(part 1 of 2)
# Autodesk Inventor assembly: Final Design v2
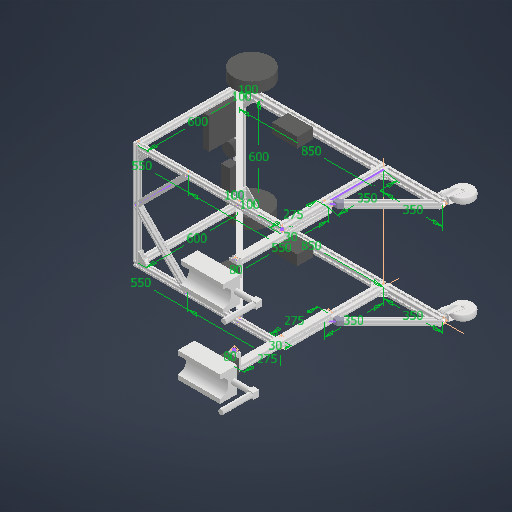
[picture p0: Inventor's stored thumbnail of the model, 512x512]
Saved by Autodesk Inventor 2026 (Build 300175050, 175E)
## iProperties
Created: 2026-09-14
Part Number: Final Design v2
Catalog Web Link: www.boschrexroth.com/brl
Description: Assembly
Vendor: Bosch Rexroth AG - BRL
Document SubType Name: Assembly
Designer: Anura
Mass: 32963.5 g
Surface Area: 66921.5 cm^2
Volume: 21111.2 cm^3
Density: 1.56143 g/cm^3
ProductId: Bosch Rexroth AG
Sending System: Bosch Rexroth AG
Author: Anura
## Documents named in this file (45)
- C:\Uni\Bachelorarbeit\CAD\Final Design v2\Final Design v2.iam
- Final Design v2.iam
- C:\Uni\Bachelorarbeit\CAD\Electronic Parts\Final Design Frame.ipt
- C:\Uni\Bachelorarbeit\CAD\Electronic Parts\Handles.ipt
- C:\Uni\Bachelorarbeit\CAD\Final Design v2\3842993724_STRUT PROFILE 40x40L_h150_260914151208250.ipt
- C:\Uni\Bachelorarbeit\CAD\Final Design v2\3842993724_STRUT PROFILE 40x40L_h150_260914151213792.ipt
- C:\Uni\Bachelorarbeit\CAD\Final Design v2\3842993724_STRUT PROFILE 40x40L_h150_260914151219216.ipt
- C:\Uni\Bachelorarbeit\CAD\Final Design v2\3842993724_STRUT PROFILE 40x40L_h150_260914151223655.ipt
- C:\Uni\Bachelorarbeit\CAD\Final Design v2\3842993724_STRUT PROFILE 40x40L_h150_260914151227681.ipt
- C:\Uni\Bachelorarbeit\CAD\Final Design v2\3842993710_STRUT PROFILE 30x45_h150_260914151454532.ipt
- C:\Uni\Bachelorarbeit\CAD\Final Design v2\3842993710_STRUT PROFILE 30x45_h150_260914151506771.ipt
- C:\Uni\Bachelorarbeit\CAD\Final Design v2\3842993710_STRUT PROFILE 30x45_h150_260914152027788.ipt
- C:\Uni\Bachelorarbeit\CAD\Final Design v2\3842993710_STRUT PROFILE 30x45_h150_260914152035980.ipt
- C:\Uni\Bachelorarbeit\CAD\Final Design v2\3842993710_STRUT PROFILE 30x45_h150_260914152234607.ipt
- C:\Uni\Bachelorarbeit\CAD\Final Design v2\3842993710_STRUT PROFILE 30x45_h150_260914152246414.ipt
- C:\Uni\Bachelorarbeit\CAD\Final Design v2\3842993703_STRUT PROFILE 30x30_h150_260914152755553.ipt
- C:\Uni\Bachelorarbeit\CAD\Final Design v2\3842993703_STRUT PROFILE 30x30_h150_260914152759129.ipt
- C:\Uni\Bachelorarbeit\CAD\Final Design v2\3842993703_STRUT PROFILE 30x30_h150_260914152806460.ipt
- C:\Uni\Bachelorarbeit\CAD\Final Design v2\3842993703_STRUT PROFILE 30x30_h150_260914152813741.ipt
- C:\Uni\Bachelorarbeit\CAD\Final Design v2\3842993703_STRUT PROFILE 30x30_h150_260914152817399.ipt
- C:\Uni\Bachelorarbeit\CAD\Final Design v2\3842993703_STRUT PROFILE 30x30_h150_260914152821085.ipt
- C:\Uni\Bachelorarbeit\CAD\Final Design v2\3842993703_STRUT PROFILE 30x30_h150_260914152832296.ipt
- C:\Uni\Bachelorarbeit\CAD\Final Design v2\3842993703_STRUT PROFILE 30x30_h150_260914152836142.ipt
- C:\Uni\Bachelorarbeit\CAD\Final Design v2\3842993703_STRUT PROFILE 30x30_h150_260914152843769.ipt
- C:\Uni\Bachelorarbeit\CAD\Final Design v2\3842993703_STRUT PROFILE 30x30_h150_260914152847624.ipt
- C:\Uni\Bachelorarbeit\CAD\Final Design v2\3842993703_STRUT PROFILE 30x30_h150_260915130417955.ipt
- C:\Uni\Bachelorarbeit\CAD\Final Design v2\3842993703_STRUT PROFILE 30x30_h150_260915130422752.ipt
- C:\Uni\Bachelorarbeit\CAD\Final Design v2\3842993703_STRUT PROFILE 30x30_h150_260915130427114.ipt
- C:\Uni\Bachelorarbeit\CAD\Final Design v2\3842993703_STRUT PROFILE 30x30_h150_260915130431463.ipt
- C:\Uni\Bachelorarbeit\CAD\Final Design v2\3842993703_STRUT PROFILE 30x30_h150_260915130435922.ipt
- C:\Uni\Bachelorarbeit\CAD\Final Design v2\3842993703_STRUT PROFILE 30x30_h150_260915130440308.ipt
- C:\Uni\Bachelorarbeit\CAD\Final Design v2\3842993703_STRUT PROFILE 30x30_h150_260915130444799.ipt
- C:\Uni\Bachelorarbeit\CAD\Final Design v2\3842993703_STRUT PROFILE 30x30_h150_260915130449323.ipt
- C:\Uni\Bachelorarbeit\CAD\Final Design v2\3842538683_Joint 30x30_150_260915130804560.iam
- C:\Uni\Bachelorarbeit\CAD\Final Design v2\3842554447_45° CONNECTOR, 30X30_h150_260915131009700_HD.ipt
- C:\Uni\Bachelorarbeit\CAD\Final Design v2\3842551604_GUSSET 40X80_h150_260915132254954_HD.ipt
- C:\Uni\Bachelorarbeit\CAD\Final Design v2\3842523541_GUSSET 30_60_h150_260915132538990_HD.ipt
- C:\Uni\Bachelorarbeit\CAD\Electronic Parts\Wheel.ipt
- C:\Uni\Bachelorarbeit\CAD\Final Design v1\3842541240_CASTER WHEEL_h150_260717015253432_HD.ipt
- C:\Uni\Bachelorarbeit\CAD\Electronic Parts\Forcesensor.ipt
- C:\Uni\Bachelorarbeit\CAD\Final Design v2\3842523530_GUSSET 30_30_h150_260919162252829_HD.ipt
- C:\Uni\Bachelorarbeit\CAD\Electronic Parts\Part11.ipt
- C:\Uni\Bachelorarbeit\CAD\Electronic Parts\MiniPC.ipt
- C:\Uni\Bachelorarbeit\CAD\Electronic Parts\lidar.ipt
- C:\Uni\Bachelorarbeit\CAD\Electronic Parts\powerbank.ipt
## Components (59 placed, 54 different names)
1. Final Design Frame:1 — BR_Constraint_Mate_091215121408026_P1, BR_Constraint_Mate_091215121408026_P2, BR_Constraint_Mate_091215121408026_P3, BR_Constraint_Mate_091215121408026_P4, BR_Constraint_Mate_091215151466926_P1, BR_Constraint_Mate_091215151466926_P2, BR_Constraint_Mate_091215151466926_P3, BR_Constraint_Mate_091215151466926_P4, BR_Constraint_Mate_091215211406126_P1, BR_Constraint_Mate_091215211406126_P2, BR_Constraint_Mate_091215211406126_P3, BR_Constraint_Mate_091215211406126_P4, BR_Constraint_Mate_091215251456626_P1, BR_Constraint_Mate_091215251456626_P2, BR_Constraint_Mate_091215251456626_P3, BR_Constraint_Mate_091215251456626_P4, BR_Constraint_Mate_091215291455626_P1, BR_Constraint_Mate_091215291455626_P2, BR_Constraint_Mate_091215291455626_P3, BR_Constraint_Mate_091215291455626_P4, BR_Constraint_Mate_091515011495426_P1, BR_Constraint_Mate_091515011495426_P2, BR_Constraint_Mate_091515011495426_P3, BR_Constraint_Mate_091515011495426_P4, BR_Constraint_Mate_091515081458926_P1, BR_Constraint_Mate_091515081458926_P2, BR_Constraint_Mate_091515081458926_P3, BR_Constraint_Mate_091515081458926_P4, BR_Constraint_Mate_092015301495626_P1, BR_Constraint_Mate_092015301495626_P2, BR_Constraint_Mate_092015301495626_P3, BR_Constraint_Mate_092015301495626_P4, BR_Constraint_Mate_092015391417226_P1, BR_Constraint_Mate_092015391417226_P2, BR_Constraint_Mate_092015391417226_P3, BR_Constraint_Mate_092015391417226_P4, BR_Constraint_Mate_092215381408426_P1, BR_Constraint_Mate_092215381408426_P2, BR_Constraint_Mate_092215381408426_P3, BR_Constraint_Mate_092215381408426_P4, BR_Constraint_Mate_092215501404826_P1, BR_Constraint_Mate_092215501404826_P2, BR_Constraint_Mate_092215501404826_P3, BR_Constraint_Mate_092215501404826_P4, BR_Constraint_Mate_092715581486526_P1, BR_Constraint_Mate_092715581486526_P2, BR_Constraint_Mate_092715581486526_P3, BR_Constraint_Mate_092715581486526_P4, BR_Constraint_Mate_092815021443226_P1, BR_Constraint_Mate_092815021443226_P2, BR_Constraint_Mate_092815021443226_P3, BR_Constraint_Mate_092815021443226_P4, BR_Constraint_Mate_092815091475826_P1, BR_Constraint_Mate_092815091475826_P2, BR_Constraint_Mate_092815091475826_P3, BR_Constraint_Mate_092815091475826_P4, BR_Constraint_Mate_092815171409326_P1, BR_Constraint_Mate_092815171409326_P2, BR_Constraint_Mate_092815171409326_P3, BR_Constraint_Mate_092815171409326_P4, BR_Constraint_Mate_092815201476326_P1, BR_Constraint_Mate_092815201476326_P2, BR_Constraint_Mate_092815201476326_P3, BR_Constraint_Mate_092815201476326_P4, BR_Constraint_Mate_092815241448326_P1, BR_Constraint_Mate_092815241448326_P2, BR_Constraint_Mate_092815241448326_P3, BR_Constraint_Mate_092815241448326_P4, BR_Constraint_Mate_092815351481726_P1, BR_Constraint_Mate_092815351481726_P2, BR_Constraint_Mate_092815351481726_P3, BR_Constraint_Mate_092815351481726_P4, BR_Constraint_Mate_092815391458826_P1, BR_Constraint_Mate_092815391458826_P2, BR_Constraint_Mate_092815391458826_P3, BR_Constraint_Mate_092815391458826_P4, BR_Constraint_Mate_092815471426826_P1, BR_Constraint_Mate_092815471426826_P2, BR_Constraint_Mate_092815471426826_P3, BR_Constraint_Mate_092815471426826_P4, BR_Constraint_Mate_092815511432826_P1, BR_Constraint_Mate_092815511432826_P2, BR_Constraint_Mate_092815511432826_P3, BR_Constraint_Mate_092815511432826_P4, BR_Constraint_Mate_090413221527926_P1, BR_Constraint_Mate_090413221527926_P2, BR_Constraint_Mate_090413221527926_P3, BR_Constraint_Mate_090413221527926_P4, BR_Constraint_Mate_090413261575826_P1, BR_Constraint_Mate_090413261575826_P2, BR_Constraint_Mate_090413261575826_P3, BR_Constraint_Mate_090413261575826_P4, BR_Constraint_Mate_090413311512826_P1, BR_Constraint_Mate_090413311512826_P2, BR_Constraint_Mate_090413311512826_P3, BR_Constraint_Mate_090413311512826_P4, BR_Constraint_Mate_090413351558326_P1, BR_Constraint_Mate_090413351558326_P2, BR_Constraint_Mate_090413351558326_P3, BR_Constraint_Mate_090413351558326_P4, BR_Constraint_Mate_090413391593726_P1, BR_Constraint_Mate_090413391593726_P2, BR_Constraint_Mate_090413391593726_P3, BR_Constraint_Mate_090413391593726_P4, BR_Constraint_Mate_090413441540226_P1, BR_Constraint_Mate_090413441540226_P2, BR_Constraint_Mate_090413441540226_P3, BR_Constraint_Mate_090413441540226_P4, BR_Constraint_Mate_090413481594026_P1, BR_Constraint_Mate_090413481594026_P2, BR_Constraint_Mate_090413481594026_P3, BR_Constraint_Mate_090413481594026_P4, BR_Constraint_Mate_090413531539226_P1, BR_Constraint_Mate_090413531539226_P2, BR_Constraint_Mate_090413531539226_P3, BR_Constraint_Mate_090413531539226_P4
2. Handles:1
3. Handles:2
4. Wheel:1
5. Wheel:2
6. 3842541240_CASTER WHEEL_h150_260717015253432_HD:1
7. 3842541240_CASTER WHEEL_h150_260717015253432_HD:2
8. Forcesensor:1
9. Forcesensor:2
10. Part11:1
11. Part11:2
12. MiniPC:1
13. lidar:1
14. powerbank:1
15. 3842993703_STRUT PROFILE 30x30_h150_260915130449323:1 — BR_Constraint_Mate_090413531539226_P1, BR_Constraint_Mate_090413531539226_P2, BR_Constraint_Mate_090413531539226_P3, BR_Constraint_Mate_090413531539226_P4, BR_Constraint_Angle_090413531539226_P5, BR_Constraint_Mate_TCon_FC_065265409111513_1_1, BR_Constraint_Mate_TCon_FC_065265409111513_2_2, BR_Constraint_Flush_FCon_FC_065265409111513_1_3
16. 3842993703_STRUT PROFILE 30x30_h150_260915130444799:1 — BR_Constraint_Mate_090413481594026_P1, BR_Constraint_Mate_090413481594026_P2, BR_Constraint_Mate_090413481594026_P3, BR_Constraint_Mate_090413481594026_P4, BR_Constraint_Angle_090413481594026_P5, BR_Constraint_Mate_TCon_FC_914260009111513_1_1, BR_Constraint_Mate_TCon_FC_914260009111513_2_2, BR_Constraint_Flush_FCon_FC_914260009111513_1_3
17. 3842993703_STRUT PROFILE 30x30_h150_260915130440308:1 — BR_Constraint_Mate_090413441540226_P1, BR_Constraint_Mate_090413441540226_P2, BR_Constraint_Mate_090413441540226_P3, BR_Constraint_Mate_090413441540226_P4, BR_Constraint_Angle_090413441540226_P5, BR_Constraint_Mate_BC_990263809251513_1_3, BR_Constraint_Mate_BC_887262809231916_1_3
18. 3842993703_STRUT PROFILE 30x30_h150_260915130435922:1 — BR_Constraint_Mate_090413391593726_P1, BR_Constraint_Mate_090413391593726_P2, BR_Constraint_Mate_090413391593726_P3, BR_Constraint_Mate_090413391593726_P4, BR_Constraint_Angle_090413391593726_P5, BR_Constraint_Flush_BC_470261209261513_1_1, BR_Constraint_Flush_BC_470261209261513_1_2
19. 3842993703_STRUT PROFILE 30x30_h150_260915130431463:1 — BR_Constraint_Mate_090413351558326_P1, BR_Constraint_Mate_090413351558326_P2, BR_Constraint_Mate_090413351558326_P3, BR_Constraint_Mate_090413351558326_P4, BR_Constraint_Angle_090413351558326_P5
20. 3842993703_STRUT PROFILE 30x30_h150_260915130427114:1 — BR_Constraint_Mate_090413311512826_P1, BR_Constraint_Mate_090413311512826_P2, BR_Constraint_Mate_090413311512826_P3, BR_Constraint_Mate_090413311512826_P4, BR_Constraint_Angle_090413311512826_P5, BR_Constraint_Mate_BC_990263809251513_1_1, BR_Constraint_Flush_BC_990263809251513_1_2, BR_Constraint_Mate_BC_470261209261513_1_3, BR_Constraint_Mate_BC_441262309231916_1_1, BR_Constraint_Mate_BC_441262309231916_1_2
21. 3842993703_STRUT PROFILE 30x30_h150_260915130422752:1 — BR_Constraint_Mate_090413261575826_P1, BR_Constraint_Mate_090413261575826_P2, BR_Constraint_Mate_090413261575826_P3, BR_Constraint_Mate_090413261575826_P4, BR_Constraint_Angle_090413261575826_P5, BR_Constraint_Mate_BC_441262309231916_1_3, BR_Constraint_Mate_BC_887262809231916_1_1, BR_Constraint_Flush_BC_887262809231916_1_2
22. 3842993703_STRUT PROFILE 30x30_h150_260915130417955:1 — BR_Constraint_Mate_090413221527926_P1, BR_Constraint_Mate_090413221527926_P2, BR_Constraint_Mate_090413221527926_P3, BR_Constraint_Mate_090413221527926_P4, BR_Constraint_Angle_090413221527926_P5, BR_Constraint_Mate_BC_955263809231916_1_3
23. 3842993703_STRUT PROFILE 30x30_h150_260914152847624:1 — BR_Constraint_Mate_092815511432826_P1, BR_Constraint_Mate_092815511432826_P2, BR_Constraint_Mate_092815511432826_P3, BR_Constraint_Mate_092815511432826_P4, BR_Constraint_Angle_092815511432826_P5
24. 3842993703_STRUT PROFILE 30x30_h150_260914152843769:1 — BR_Constraint_Mate_092815471426826_P1, BR_Constraint_Mate_092815471426826_P2, BR_Constraint_Mate_092815471426826_P3, BR_Constraint_Mate_092815471426826_P4, BR_Constraint_Angle_092815471426826_P5
25. 3842993703_STRUT PROFILE 30x30_h150_260914152836142:1 — BR_Constraint_Mate_092815391458826_P1, BR_Constraint_Mate_092815391458826_P2, BR_Constraint_Mate_092815391458826_P3, BR_Constraint_Mate_092815391458826_P4, BR_Constraint_Angle_092815391458826_P5
26. 3842993703_STRUT PROFILE 30x30_h150_260914152832296:1 — BR_Constraint_Mate_092815351481726_P1, BR_Constraint_Mate_092815351481726_P2, BR_Constraint_Mate_092815351481726_P3, BR_Constraint_Mate_092815351481726_P4, BR_Constraint_Angle_092815351481726_P5
27. 3842993703_STRUT PROFILE 30x30_h150_260914152821085:1 — BR_Constraint_Mate_092815241448326_P1, BR_Constraint_Mate_092815241448326_P2, BR_Constraint_Mate_092815241448326_P3, BR_Constraint_Mate_092815241448326_P4, BR_Constraint_Angle_092815241448326_P5
28. 3842993703_STRUT PROFILE 30x30_h150_260914152817399:1 — BR_Constraint_Mate_092815201476326_P1, BR_Constraint_Mate_092815201476326_P2, BR_Constraint_Mate_092815201476326_P3, BR_Constraint_Mate_092815201476326_P4, BR_Constraint_Angle_092815201476326_P5
29. 3842993703_STRUT PROFILE 30x30_h150_260914152813741:1 — BR_Constraint_Mate_092815171409326_P1, BR_Constraint_Mate_092815171409326_P2, BR_Constraint_Mate_092815171409326_P3, BR_Constraint_Mate_092815171409326_P4, BR_Constraint_Angle_092815171409326_P5, BR_Constraint_Mate_TCon_FC_759260609141513_1_1, BR_Constraint_Mate_TCon_FC_759260609141513_2_2, BR_Constraint_Flush_FCon_FC_759260609141513_1_3
30. 3842993703_STRUT PROFILE 30x30_h150_260914152806460:1 — BR_Constraint_Mate_092815091475826_P1, BR_Constraint_Mate_092815091475826_P2, BR_Constraint_Mate_092815091475826_P3, BR_Constraint_Mate_092815091475826_P4, BR_Constraint_Angle_092815091475826_P5, BR_Constraint_Mate_TCon_FC_422263309141513_1_1, BR_Constraint_Mate_TCon_FC_422263309141513_2_2, BR_Constraint_Flush_FCon_FC_422263309141513_1_3
31. 3842993703_STRUT PROFILE 30x30_h150_260914152759129:1 — BR_Constraint_Mate_092815021443226_P1, BR_Constraint_Mate_092815021443226_P2, BR_Constraint_Mate_092815021443226_P3, BR_Constraint_Mate_092815021443226_P4, BR_Constraint_Angle_092815021443226_P5
32. 3842993703_STRUT PROFILE 30x30_h150_260914152755553:1 — BR_Constraint_Mate_092715581486526_P1, BR_Constraint_Mate_092715581486526_P2, BR_Constraint_Mate_092715581486526_P3, BR_Constraint_Mate_092715581486526_P4, BR_Constraint_Angle_092715581486526_P5
33. 3842993710_STRUT PROFILE 30x45_h150_260914152246414:1 — BR_Constraint_Mate_092215501404826_P1, BR_Constraint_Mate_092215501404826_P2, BR_Constraint_Mate_092215501404826_P3, BR_Constraint_Mate_092215501404826_P4, BR_Constraint_Angle_092215501404826_P5, BR_Constraint_Mate_BC_492263609261916_1_3
34. 3842993710_STRUT PROFILE 30x45_h150_260914152234607:1 — BR_Constraint_Mate_092215381408426_P1, BR_Constraint_Mate_092215381408426_P2, BR_Constraint_Mate_092215381408426_P3, BR_Constraint_Mate_092215381408426_P4, BR_Constraint_Angle_092215381408426_P5
35. 3842993710_STRUT PROFILE 30x45_h150_260914152035980:1 — BR_Constraint_Mate_092015391417226_P1, BR_Constraint_Mate_092015391417226_P2, BR_Constraint_Mate_092015391417226_P3, BR_Constraint_Mate_092015391417226_P4, BR_Constraint_Angle_092015391417226_P5, BR_Constraint_Mate_BC_492263609261916_1_1, BR_Constraint_Mate_BC_492263609261916_1_2
36. 3842993710_STRUT PROFILE 30x45_h150_260914152027788:1 — BR_Constraint_Mate_092015301495626_P1, BR_Constraint_Mate_092015301495626_P2, BR_Constraint_Mate_092015301495626_P3, BR_Constraint_Mate_092015301495626_P4, BR_Constraint_Angle_092015301495626_P5
37. 3842993710_STRUT PROFILE 30x45_h150_260914151506771:1 — BR_Constraint_Mate_091515081458926_P1, BR_Constraint_Mate_091515081458926_P2, BR_Constraint_Mate_091515081458926_P3, BR_Constraint_Mate_091515081458926_P4, BR_Constraint_Angle_091515081458926_P5, BR_Constraint_Mate_BC_977262809241916_1_3, BR_Constraint_Mate_BC_648263509241916_1_3
38. 3842993710_STRUT PROFILE 30x45_h150_260914151454532:1 — BR_Constraint_Mate_091515011495426_P1, BR_Constraint_Mate_091515011495426_P2, BR_Constraint_Mate_091515011495426_P3, BR_Constraint_Mate_091515011495426_P4, BR_Constraint_Angle_091515011495426_P5, BR_Constraint_Mate_BC_830261309241916_1_3, BR_Constraint_Mate_BC_326262109241916_1_3
39. 3842993724_STRUT PROFILE 40x40L_h150_260914151227681:1 — BR_Constraint_Mate_091215291455626_P1, BR_Constraint_Mate_091215291455626_P2, BR_Constraint_Mate_091215291455626_P3, BR_Constraint_Mate_091215291455626_P4, BR_Constraint_Angle_091215291455626_P5, BR_Constraint_Mate_BC_954265409221513_1_3, BR_Constraint_Mate_BC_821261309231513_1_3, BR_Constraint_Mate_BC_955263809231916_1_1, BR_Constraint_Mate_BC_955263809231916_1_2
40. 3842993724_STRUT PROFILE 40x40L_h150_260914151223655:1 — BR_Constraint_Mate_091215251456626_P1, BR_Constraint_Mate_091215251456626_P2, BR_Constraint_Mate_091215251456626_P3, BR_Constraint_Mate_091215251456626_P4, BR_Constraint_Angle_091215251456626_P5, BR_Constraint_Flush_BC_326262109241916_1_1, BR_Constraint_Mate_BC_326262109241916_1_2
41. 3842993724_STRUT PROFILE 40x40L_h150_260914151219216:1 — BR_Constraint_Mate_091215211406126_P1, BR_Constraint_Mate_091215211406126_P2, BR_Constraint_Mate_091215211406126_P3, BR_Constraint_Mate_091215211406126_P4, BR_Constraint_Angle_091215211406126_P5, BR_Constraint_Mate_BC_821261309231513_1_1, BR_Constraint_Flush_BC_821261309231513_1_2, BR_Constraint_Mate_BC_830261309241916_1_1, BR_Constraint_Flush_BC_830261309241916_1_2
42. 3842993724_STRUT PROFILE 40x40L_h150_260914151213792:1 — BR_Constraint_Mate_091215151466926_P1, BR_Constraint_Mate_091215151466926_P2, BR_Constraint_Mate_091215151466926_P3, BR_Constraint_Mate_091215151466926_P4, BR_Constraint_Angle_091215151466926_P5, BR_Constraint_Flush_BC_648263509241916_1_1, BR_Constraint_Mate_BC_648263509241916_1_2
43. 3842993724_STRUT PROFILE 40x40L_h150_260914151208250:1 — BR_Constraint_Mate_091215121408026_P1, BR_Constraint_Mate_091215121408026_P2, BR_Constraint_Mate_091215121408026_P3, BR_Constraint_Mate_091215121408026_P4, BR_Constraint_Angle_091215121408026_P5, BR_Constraint_Flush_BC_954265409221513_1_1, BR_Constraint_Flush_BC_954265409221513_1_2, BR_Constraint_Flush_BC_977262809241916_1_1, BR_Constraint_Flush_BC_977262809241916_1_2
44. 3842523530_GUSSET 30_30_h150_260919162636492 — BR_Constraint_Mate_BC_492263609261916_1_1, BR_Constraint_Mate_BC_492263609261916_1_3, BR_Constraint_Mate_BC_492263609261916_1_2
45. 3842523530_GUSSET 30_30_h150_260919162435648 — BR_Constraint_Flush_BC_648263509241916_1_1, BR_Constraint_Mate_BC_648263509241916_1_3, BR_Constraint_Mate_BC_648263509241916_1_2
46. 3842523530_GUSSET 30_30_h150_260919162428977 — BR_Constraint_Flush_BC_977262809241916_1_1, BR_Constraint_Mate_BC_977262809241916_1_3, BR_Constraint_Flush_BC_977262809241916_1_2
47. 3842523530_GUSSET 30_30_h150_260919162421326 — BR_Constraint_Flush_BC_326262109241916_1_1, BR_Constraint_Mate_BC_326262109241916_1_3, BR_Constraint_Mate_BC_326262109241916_1_2
48. 3842523530_GUSSET 30_30_h150_260919162413830 — BR_Constraint_Mate_BC_830261309241916_1_1, BR_Constraint_Mate_BC_830261309241916_1_3, BR_Constraint_Flush_BC_830261309241916_1_2
49. 3842523530_GUSSET 30_30_h150_260919162338955 — BR_Constraint_Mate_BC_955263809231916_1_1, BR_Constraint_Mate_BC_955263809231916_1_3, BR_Constraint_Mate_BC_955263809231916_1_2
50. 3842523530_GUSSET 30_30_h150_260919162328887 — BR_Constraint_Mate_BC_887262809231916_1_1, BR_Constraint_Mate_BC_887262809231916_1_3, BR_Constraint_Flush_BC_887262809231916_1_2
51. 3842523530_GUSSET 30_30_h150_260919162323441 — BR_Constraint_Mate_BC_441262309231916_1_1, BR_Constraint_Mate_BC_441262309231916_1_3, BR_Constraint_Mate_BC_441262309231916_1_2
52. 3842523541_GUSSET 30_60_h150_260915132612470 — BR_Constraint_Flush_BC_470261209261513_1_1, BR_Constraint_Mate_BC_470261209261513_1_3, BR_Constraint_Flush_BC_470261209261513_1_2
53. 3842523541_GUSSET 30_60_h150_260915132538990 — BR_Constraint_Mate_BC_990263809251513_1_1, BR_Constraint_Mate_BC_990263809251513_1_3, BR_Constraint_Flush_BC_990263809251513_1_2
54. 3842551604_GUSSET 40X80_h150_260915132313821 — BR_Constraint_Mate_BC_821261309231513_1_1, BR_Constraint_Mate_BC_821261309231513_1_3, BR_Constraint_Flush_BC_821261309231513_1_2
55. 3842551604_GUSSET 40X80_h150_260915132254954 — BR_Constraint_Flush_BC_954265409221513_1_1, BR_Constraint_Mate_BC_954265409221513_1_3, BR_Constraint_Flush_BC_954265409221513_1_2
56. 3842554447_45° CONNECTOR, 30X30_h150_260915131433422 — BR_Constraint_Mate_TCon_FC_422263309141513_1_1, BR_Constraint_Mate_TCon_FC_422263309141513_2_2, BR_Constraint_Flush_FCon_FC_422263309141513_1_3
57. 3842554447_45° CONNECTOR, 30X30_h150_260915131406759 — BR_Constraint_Mate_TCon_FC_759260609141513_1_1, BR_Constraint_Mate_TCon_FC_759260609141513_2_2, BR_Constraint_Flush_FCon_FC_759260609141513_1_3
58. 3842554447_45° CONNECTOR, 30X30_h150_260915131154065 — BR_Constraint_Mate_TCon_FC_065265409111513_1_1, BR_Constraint_Mate_TCon_FC_065265409111513_2_2, BR_Constraint_Flush_FCon_FC_065265409111513_1_3
59. 3842554447_45° CONNECTOR, 30X30_h150_260915131100914 — BR_Constraint_Mate_TCon_FC_914260009111513_1_1, BR_Constraint_Mate_TCon_FC_914260009111513_2_2, BR_Constraint_Flush_FCon_FC_914260009111513_1_3
## Relationships (193: Mate 139, Angle 29, Flush 25)
- BR_Constraint_Mate_091215121408026_P1 [Mate]: Final Design Frame:1 ↔ 3842993724_STRUT PROFILE 40x40L_h150_260914151208250:1
- BR_Constraint_Mate_091215121408026_P2 [Mate]: Final Design Frame:1 ↔ 3842993724_STRUT PROFILE 40x40L_h150_260914151208250:1
- BR_Constraint_Mate_091215121408026_P3 [Mate] (-425 mm): Final Design Frame:1 ↔ 3842993724_STRUT PROFILE 40x40L_h150_260914151208250:1
- BR_Constraint_Mate_091215121408026_P4 [Mate] (425 mm): Final Design Frame:1 ↔ 3842993724_STRUT PROFILE 40x40L_h150_260914151208250:1
- BR_Constraint_Angle_091215121408026_P5 [Angle] (0 deg): 3842993724_STRUT PROFILE 40x40L_h150_260914151208250:1
- BR_Constraint_Mate_091215151466926_P1 [Mate]: Final Design Frame:1 ↔ 3842993724_STRUT PROFILE 40x40L_h150_260914151213792:1
- BR_Constraint_Mate_091215151466926_P2 [Mate]: Final Design Frame:1 ↔ 3842993724_STRUT PROFILE 40x40L_h150_260914151213792:1
- BR_Constraint_Mate_091215151466926_P3 [Mate] (-175 mm): Final Design Frame:1 ↔ 3842993724_STRUT PROFILE 40x40L_h150_260914151213792:1
- BR_Constraint_Mate_091215151466926_P4 [Mate] (175 mm): Final Design Frame:1 ↔ 3842993724_STRUT PROFILE 40x40L_h150_260914151213792:1
- BR_Constraint_Angle_091215151466926_P5 [Angle] (0 deg): 3842993724_STRUT PROFILE 40x40L_h150_260914151213792:1
- BR_Constraint_Mate_091215211406126_P1 [Mate]: Final Design Frame:1 ↔ 3842993724_STRUT PROFILE 40x40L_h150_260914151219216:1
- BR_Constraint_Mate_091215211406126_P2 [Mate]: Final Design Frame:1 ↔ 3842993724_STRUT PROFILE 40x40L_h150_260914151219216:1
- BR_Constraint_Mate_091215211406126_P3 [Mate] (-425 mm): Final Design Frame:1 ↔ 3842993724_STRUT PROFILE 40x40L_h150_260914151219216:1
- BR_Constraint_Mate_091215211406126_P4 [Mate] (425 mm): Final Design Frame:1 ↔ 3842993724_STRUT PROFILE 40x40L_h150_260914151219216:1
- BR_Constraint_Angle_091215211406126_P5 [Angle] (0 deg): 3842993724_STRUT PROFILE 40x40L_h150_260914151219216:1
- BR_Constraint_Mate_091215251456626_P1 [Mate]: Final Design Frame:1 ↔ 3842993724_STRUT PROFILE 40x40L_h150_260914151223655:1
- BR_Constraint_Mate_091215251456626_P2 [Mate]: Final Design Frame:1 ↔ 3842993724_STRUT PROFILE 40x40L_h150_260914151223655:1
- BR_Constraint_Mate_091215251456626_P3 [Mate] (-175 mm): Final Design Frame:1 ↔ 3842993724_STRUT PROFILE 40x40L_h150_260914151223655:1
- BR_Constraint_Mate_091215251456626_P4 [Mate] (175 mm): Final Design Frame:1 ↔ 3842993724_STRUT PROFILE 40x40L_h150_260914151223655:1
- BR_Constraint_Angle_091215251456626_P5 [Angle] (0 deg): 3842993724_STRUT PROFILE 40x40L_h150_260914151223655:1
- BR_Constraint_Mate_091215291455626_P1 [Mate]: Final Design Frame:1 ↔ 3842993724_STRUT PROFILE 40x40L_h150_260914151227681:1
- BR_Constraint_Mate_091215291455626_P2 [Mate]: Final Design Frame:1 ↔ 3842993724_STRUT PROFILE 40x40L_h150_260914151227681:1
- BR_Constraint_Mate_091215291455626_P3 [Mate] (-300 mm): Final Design Frame:1 ↔ 3842993724_STRUT PROFILE 40x40L_h150_260914151227681:1
- BR_Constraint_Mate_091215291455626_P4 [Mate] (300 mm): Final Design Frame:1 ↔ 3842993724_STRUT PROFILE 40x40L_h150_260914151227681:1
- BR_Constraint_Angle_091215291455626_P5 [Angle] (0 deg): 3842993724_STRUT PROFILE 40x40L_h150_260914151227681:1
- BR_Constraint_Mate_091515011495426_P1 [Mate]: Final Design Frame:1 ↔ 3842993710_STRUT PROFILE 30x45_h150_260914151454532:1
- BR_Constraint_Mate_091515011495426_P2 [Mate]: Final Design Frame:1 ↔ 3842993710_STRUT PROFILE 30x45_h150_260914151454532:1
- BR_Constraint_Mate_091515011495426_P3 [Mate] (-299.8546 mm): Final Design Frame:1 ↔ 3842993710_STRUT PROFILE 30x45_h150_260914151454532:1
- BR_Constraint_Mate_091515011495426_P4 [Mate] (299.8546 mm): Final Design Frame:1 ↔ 3842993710_STRUT PROFILE 30x45_h150_260914151454532:1
- BR_Constraint_Angle_091515011495426_P5 [Angle] (0 deg): 3842993710_STRUT PROFILE 30x45_h150_260914151454532:1
- BR_Constraint_Mate_091515081458926_P1 [Mate]: Final Design Frame:1 ↔ 3842993710_STRUT PROFILE 30x45_h150_260914151506771:1
- BR_Constraint_Mate_091515081458926_P2 [Mate]: Final Design Frame:1 ↔ 3842993710_STRUT PROFILE 30x45_h150_260914151506771:1
- BR_Constraint_Mate_091515081458926_P3 [Mate] (-300.0021 mm): Final Design Frame:1 ↔ 3842993710_STRUT PROFILE 30x45_h150_260914151506771:1
- BR_Constraint_Mate_091515081458926_P4 [Mate] (300.0021 mm): Final Design Frame:1 ↔ 3842993710_STRUT PROFILE 30x45_h150_260914151506771:1
- BR_Constraint_Angle_091515081458926_P5 [Angle] (0 deg): 3842993710_STRUT PROFILE 30x45_h150_260914151506771:1
- BR_Constraint_Mate_092015301495626_P1 [Mate]: Final Design Frame:1 ↔ 3842993710_STRUT PROFILE 30x45_h150_260914152027788:1
- BR_Constraint_Mate_092015301495626_P2 [Mate]: Final Design Frame:1 ↔ 3842993710_STRUT PROFILE 30x45_h150_260914152027788:1
- BR_Constraint_Mate_092015301495626_P3 [Mate] (-275 mm): Final Design Frame:1 ↔ 3842993710_STRUT PROFILE 30x45_h150_260914152027788:1
- BR_Constraint_Mate_092015301495626_P4 [Mate] (275 mm): Final Design Frame:1 ↔ 3842993710_STRUT PROFILE 30x45_h150_260914152027788:1
- BR_Constraint_Angle_092015301495626_P5 [Angle] (0 deg): 3842993710_STRUT PROFILE 30x45_h150_260914152027788:1
- BR_Constraint_Mate_092015391417226_P1 [Mate]: Final Design Frame:1 ↔ 3842993710_STRUT PROFILE 30x45_h150_260914152035980:1
- BR_Constraint_Mate_092015391417226_P2 [Mate]: Final Design Frame:1 ↔ 3842993710_STRUT PROFILE 30x45_h150_260914152035980:1
- BR_Constraint_Mate_092015391417226_P3 [Mate] (-275 mm): Final Design Frame:1 ↔ 3842993710_STRUT PROFILE 30x45_h150_260914152035980:1
- BR_Constraint_Mate_092015391417226_P4 [Mate] (275 mm): Final Design Frame:1 ↔ 3842993710_STRUT PROFILE 30x45_h150_260914152035980:1
- BR_Constraint_Angle_092015391417226_P5 [Angle] (0 deg): 3842993710_STRUT PROFILE 30x45_h150_260914152035980:1
- BR_Constraint_Mate_092215381408426_P1 [Mate]: Final Design Frame:1 ↔ 3842993710_STRUT PROFILE 30x45_h150_260914152234607:1
- BR_Constraint_Mate_092215381408426_P2 [Mate]: Final Design Frame:1 ↔ 3842993710_STRUT PROFILE 30x45_h150_260914152234607:1
- BR_Constraint_Mate_092215381408426_P3 [Mate] (-40 mm): Final Design Frame:1 ↔ 3842993710_STRUT PROFILE 30x45_h150_260914152234607:1
- BR_Constraint_Mate_092215381408426_P4 [Mate] (40 mm): Final Design Frame:1 ↔ 3842993710_STRUT PROFILE 30x45_h150_260914152234607:1
- BR_Constraint_Angle_092215381408426_P5 [Angle] (0 deg): 3842993710_STRUT PROFILE 30x45_h150_260914152234607:1
- BR_Constraint_Mate_092215501404826_P1 [Mate]: Final Design Frame:1 ↔ 3842993710_STRUT PROFILE 30x45_h150_260914152246414:1
- BR_Constraint_Mate_092215501404826_P2 [Mate]: Final Design Frame:1 ↔ 3842993710_STRUT PROFILE 30x45_h150_260914152246414:1
- BR_Constraint_Mate_092215501404826_P3 [Mate] (-40 mm): Final Design Frame:1 ↔ 3842993710_STRUT PROFILE 30x45_h150_260914152246414:1
- BR_Constraint_Mate_092215501404826_P4 [Mate] (40 mm): Final Design Frame:1 ↔ 3842993710_STRUT PROFILE 30x45_h150_260914152246414:1
- BR_Constraint_Angle_092215501404826_P5 [Angle] (0 deg): 3842993710_STRUT PROFILE 30x45_h150_260914152246414:1
- BR_Constraint_Mate_092715581486526_P1 [Mate]: Final Design Frame:1 ↔ 3842993703_STRUT PROFILE 30x30_h150_260914152755553:1
- BR_Constraint_Mate_092715581486526_P2 [Mate]: Final Design Frame:1 ↔ 3842993703_STRUT PROFILE 30x30_h150_260914152755553:1
- BR_Constraint_Mate_092715581486526_P3 [Mate] (-275 mm): Final Design Frame:1 ↔ 3842993703_STRUT PROFILE 30x30_h150_260914152755553:1
- BR_Constraint_Mate_092715581486526_P4 [Mate] (275 mm): Final Design Frame:1 ↔ 3842993703_STRUT PROFILE 30x30_h150_260914152755553:1
- BR_Constraint_Angle_092715581486526_P5 [Angle] (0 deg): 3842993703_STRUT PROFILE 30x30_h150_260914152755553:1
- BR_Constraint_Mate_092815021443226_P1 [Mate]: Final Design Frame:1 ↔ 3842993703_STRUT PROFILE 30x30_h150_260914152759129:1
- BR_Constraint_Mate_092815021443226_P2 [Mate]: Final Design Frame:1 ↔ 3842993703_STRUT PROFILE 30x30_h150_260914152759129:1
- BR_Constraint_Mate_092815021443226_P3 [Mate] (-275 mm): Final Design Frame:1 ↔ 3842993703_STRUT PROFILE 30x30_h150_260914152759129:1
- BR_Constraint_Mate_092815021443226_P4 [Mate] (275 mm): Final Design Frame:1 ↔ 3842993703_STRUT PROFILE 30x30_h150_260914152759129:1
- BR_Constraint_Angle_092815021443226_P5 [Angle] (0 deg): 3842993703_STRUT PROFILE 30x30_h150_260914152759129:1
- BR_Constraint_Mate_092815091475826_P1 [Mate]: Final Design Frame:1 ↔ 3842993703_STRUT PROFILE 30x30_h150_260914152806460:1
- BR_Constraint_Mate_092815091475826_P2 [Mate]: Final Design Frame:1 ↔ 3842993703_STRUT PROFILE 30x30_h150_260914152806460:1
- BR_Constraint_Mate_092815091475826_P3 [Mate] (-247.4874 mm): Final Design Frame:1 ↔ 3842993703_STRUT PROFILE 30x30_h150_260914152806460:1
- BR_Constraint_Mate_092815091475826_P4 [Mate] (247.4874 mm): Final Design Frame:1 ↔ 3842993703_STRUT PROFILE 30x30_h150_260914152806460:1
- BR_Constraint_Angle_092815091475826_P5 [Angle] (0 deg): 3842993703_STRUT PROFILE 30x30_h150_260914152806460:1
- BR_Constraint_Mate_092815171409326_P1 [Mate]: Final Design Frame:1 ↔ 3842993703_STRUT PROFILE 30x30_h150_260914152813741:1
- BR_Constraint_Mate_092815171409326_P2 [Mate]: Final Design Frame:1 ↔ 3842993703_STRUT PROFILE 30x30_h150_260914152813741:1
- BR_Constraint_Mate_092815171409326_P3 [Mate] (-247.4874 mm): Final Design Frame:1 ↔ 3842993703_STRUT PROFILE 30x30_h150_260914152813741:1
- BR_Constraint_Mate_092815171409326_P4 [Mate] (247.4874 mm): Final Design Frame:1 ↔ 3842993703_STRUT PROFILE 30x30_h150_260914152813741:1
- BR_Constraint_Angle_092815171409326_P5 [Angle] (0 deg): 3842993703_STRUT PROFILE 30x30_h150_260914152813741:1
- BR_Constraint_Mate_092815201476326_P1 [Mate]: Final Design Frame:1 ↔ 3842993703_STRUT PROFILE 30x30_h150_260914152817399:1
- BR_Constraint_Mate_092815201476326_P2 [Mate]: Final Design Frame:1 ↔ 3842993703_STRUT PROFILE 30x30_h150_260914152817399:1
- BR_Constraint_Mate_092815201476326_P3 [Mate] (-208.043 mm): Final Design Frame:1 ↔ 3842993703_STRUT PROFILE 30x30_h150_260914152817399:1
- BR_Constraint_Mate_092815201476326_P4 [Mate] (208.043 mm): Final Design Frame:1 ↔ 3842993703_STRUT PROFILE 30x30_h150_260914152817399:1
- BR_Constraint_Angle_092815201476326_P5 [Angle] (0 deg): 3842993703_STRUT PROFILE 30x30_h150_260914152817399:1
- BR_Constraint_Mate_092815241448326_P1 [Mate]: Final Design Frame:1 ↔ 3842993703_STRUT PROFILE 30x30_h150_260914152821085:1
- BR_Constraint_Mate_092815241448326_P2 [Mate]: Final Design Frame:1 ↔ 3842993703_STRUT PROFILE 30x30_h150_260914152821085:1
- BR_Constraint_Mate_092815241448326_P3 [Mate] (-214.7277 mm): Final Design Frame:1 ↔ 3842993703_STRUT PROFILE 30x30_h150_260914152821085:1
- BR_Constraint_Mate_092815241448326_P4 [Mate] (214.7277 mm): Final Design Frame:1 ↔ 3842993703_STRUT PROFILE 30x30_h150_260914152821085:1
- BR_Constraint_Angle_092815241448326_P5 [Angle] (0 deg): 3842993703_STRUT PROFILE 30x30_h150_260914152821085:1
- BR_Constraint_Mate_092815351481726_P1 [Mate]: Final Design Frame:1 ↔ 3842993703_STRUT PROFILE 30x30_h150_260914152832296:1
- BR_Constraint_Mate_092815351481726_P2 [Mate]: Final Design Frame:1 ↔ 3842993703_STRUT PROFILE 30x30_h150_260914152832296:1
- BR_Constraint_Mate_092815351481726_P3 [Mate] (-50 mm): Final Design Frame:1 ↔ 3842993703_STRUT PROFILE 30x30_h150_260914152832296:1
- BR_Constraint_Mate_092815351481726_P4 [Mate] (50 mm): Final Design Frame:1 ↔ 3842993703_STRUT PROFILE 30x30_h150_260914152832296:1
- BR_Constraint_Angle_092815351481726_P5 [Angle] (0 deg): 3842993703_STRUT PROFILE 30x30_h150_260914152832296:1
- BR_Constraint_Mate_092815391458826_P1 [Mate]: Final Design Frame:1 ↔ 3842993703_STRUT PROFILE 30x30_h150_260914152836142:1
- BR_Constraint_Mate_092815391458826_P2 [Mate]: Final Design Frame:1 ↔ 3842993703_STRUT PROFILE 30x30_h150_260914152836142:1
- BR_Constraint_Mate_092815391458826_P3 [Mate] (-50 mm): Final Design Frame:1 ↔ 3842993703_STRUT PROFILE 30x30_h150_260914152836142:1
- BR_Constraint_Mate_092815391458826_P4 [Mate] (50 mm): Final Design Frame:1 ↔ 3842993703_STRUT PROFILE 30x30_h150_260914152836142:1
- BR_Constraint_Angle_092815391458826_P5 [Angle] (0 deg): 3842993703_STRUT PROFILE 30x30_h150_260914152836142:1
- BR_Constraint_Mate_092815471426826_P1 [Mate]: Final Design Frame:1 ↔ 3842993703_STRUT PROFILE 30x30_h150_260914152843769:1
- BR_Constraint_Mate_092815471426826_P2 [Mate]: Final Design Frame:1 ↔ 3842993703_STRUT PROFILE 30x30_h150_260914152843769:1
- BR_Constraint_Mate_092815471426826_P3 [Mate] (-50 mm): Final Design Frame:1 ↔ 3842993703_STRUT PROFILE 30x30_h150_260914152843769:1
- BR_Constraint_Mate_092815471426826_P4 [Mate] (50 mm): Final Design Frame:1 ↔ 3842993703_STRUT PROFILE 30x30_h150_260914152843769:1
- BR_Constraint_Angle_092815471426826_P5 [Angle] (0 deg): 3842993703_STRUT PROFILE 30x30_h150_260914152843769:1
- BR_Constraint_Mate_092815511432826_P1 [Mate]: Final Design Frame:1 ↔ 3842993703_STRUT PROFILE 30x30_h150_260914152847624:1
- BR_Constraint_Mate_092815511432826_P2 [Mate]: Final Design Frame:1 ↔ 3842993703_STRUT PROFILE 30x30_h150_260914152847624:1
- BR_Constraint_Mate_092815511432826_P3 [Mate] (-50 mm): Final Design Frame:1 ↔ 3842993703_STRUT PROFILE 30x30_h150_260914152847624:1
- BR_Constraint_Mate_092815511432826_P4 [Mate] (50 mm): Final Design Frame:1 ↔ 3842993703_STRUT PROFILE 30x30_h150_260914152847624:1
- BR_Constraint_Angle_092815511432826_P5 [Angle] (0 deg): 3842993703_STRUT PROFILE 30x30_h150_260914152847624:1
- BR_Constraint_Mate_090413221527926_P1 [Mate]: Final Design Frame:1 ↔ 3842993703_STRUT PROFILE 30x30_h150_260915130417955:1
- BR_Constraint_Mate_090413221527926_P2 [Mate]: Final Design Frame:1 ↔ 3842993703_STRUT PROFILE 30x30_h150_260915130417955:1
- BR_Constraint_Mate_090413221527926_P3 [Mate] (-300 mm): Final Design Frame:1 ↔ 3842993703_STRUT PROFILE 30x30_h150_260915130417955:1
- BR_Constraint_Mate_090413221527926_P4 [Mate] (300 mm): Final Design Frame:1 ↔ 3842993703_STRUT PROFILE 30x30_h150_260915130417955:1
- BR_Constraint_Angle_090413221527926_P5 [Angle] (0 deg): 3842993703_STRUT PROFILE 30x30_h150_260915130417955:1
- BR_Constraint_Mate_090413261575826_P1 [Mate]: Final Design Frame:1 ↔ 3842993703_STRUT PROFILE 30x30_h150_260915130422752:1
- BR_Constraint_Mate_090413261575826_P2 [Mate]: Final Design Frame:1 ↔ 3842993703_STRUT PROFILE 30x30_h150_260915130422752:1
- BR_Constraint_Mate_090413261575826_P3 [Mate] (-300 mm): Final Design Frame:1 ↔ 3842993703_STRUT PROFILE 30x30_h150_260915130422752:1
- BR_Constraint_Mate_090413261575826_P4 [Mate] (300 mm): Final Design Frame:1 ↔ 3842993703_STRUT PROFILE 30x30_h150_260915130422752:1
- BR_Constraint_Angle_090413261575826_P5 [Angle] (0 deg): 3842993703_STRUT PROFILE 30x30_h150_260915130422752:1
- BR_Constraint_Mate_090413311512826_P1 [Mate]: Final Design Frame:1 ↔ 3842993703_STRUT PROFILE 30x30_h150_260915130427114:1
- BR_Constraint_Mate_090413311512826_P2 [Mate]: Final Design Frame:1 ↔ 3842993703_STRUT PROFILE 30x30_h150_260915130427114:1
- BR_Constraint_Mate_090413311512826_P3 [Mate] (-300 mm): Final Design Frame:1 ↔ 3842993703_STRUT PROFILE 30x30_h150_260915130427114:1
- BR_Constraint_Mate_090413311512826_P4 [Mate] (300 mm): Final Design Frame:1 ↔ 3842993703_STRUT PROFILE 30x30_h150_260915130427114:1
- BR_Constraint_Angle_090413311512826_P5 [Angle] (0 deg): 3842993703_STRUT PROFILE 30x30_h150_260915130427114:1
- BR_Constraint_Mate_090413351558326_P1 [Mate]: Final Design Frame:1 ↔ 3842993703_STRUT PROFILE 30x30_h150_260915130431463:1
- BR_Constraint_Mate_090413351558326_P2 [Mate]: Final Design Frame:1 ↔ 3842993703_STRUT PROFILE 30x30_h150_260915130431463:1
- BR_Constraint_Mate_090413351558326_P3 [Mate] (-424.2641 mm): Final Design Frame:1 ↔ 3842993703_STRUT PROFILE 30x30_h150_260915130431463:1
- BR_Constraint_Mate_090413351558326_P4 [Mate] (424.2641 mm): Final Design Frame:1 ↔ 3842993703_STRUT PROFILE 30x30_h150_260915130431463:1
- BR_Constraint_Angle_090413351558326_P5 [Angle] (0 deg): 3842993703_STRUT PROFILE 30x30_h150_260915130431463:1
- BR_Constraint_Mate_090413391593726_P1 [Mate]: Final Design Frame:1 ↔ 3842993703_STRUT PROFILE 30x30_h150_260915130435922:1
- BR_Constraint_Mate_090413391593726_P2 [Mate]: Final Design Frame:1 ↔ 3842993703_STRUT PROFILE 30x30_h150_260915130435922:1
- BR_Constraint_Mate_090413391593726_P3 [Mate] (-149.965 mm): Final Design Frame:1 ↔ 3842993703_STRUT PROFILE 30x30_h150_260915130435922:1
- BR_Constraint_Mate_090413391593726_P4 [Mate] (149.965 mm): Final Design Frame:1 ↔ 3842993703_STRUT PROFILE 30x30_h150_260915130435922:1
- BR_Constraint_Angle_090413391593726_P5 [Angle] (0 deg): 3842993703_STRUT PROFILE 30x30_h150_260915130435922:1
- BR_Constraint_Mate_090413441540226_P1 [Mate]: Final Design Frame:1 ↔ 3842993703_STRUT PROFILE 30x30_h150_260915130440308:1
- BR_Constraint_Mate_090413441540226_P2 [Mate]: Final Design Frame:1 ↔ 3842993703_STRUT PROFILE 30x30_h150_260915130440308:1
- BR_Constraint_Mate_090413441540226_P3 [Mate] (-146.9047 mm): Final Design Frame:1 ↔ 3842993703_STRUT PROFILE 30x30_h150_260915130440308:1
- BR_Constraint_Mate_090413441540226_P4 [Mate] (146.9047 mm): Final Design Frame:1 ↔ 3842993703_STRUT PROFILE 30x30_h150_260915130440308:1
- BR_Constraint_Angle_090413441540226_P5 [Angle] (0 deg): 3842993703_STRUT PROFILE 30x30_h150_260915130440308:1
- BR_Constraint_Mate_090413481594026_P1 [Mate]: Final Design Frame:1 ↔ 3842993703_STRUT PROFILE 30x30_h150_260915130444799:1
- BR_Constraint_Mate_090413481594026_P2 [Mate]: Final Design Frame:1 ↔ 3842993703_STRUT PROFILE 30x30_h150_260915130444799:1
- BR_Constraint_Mate_090413481594026_P3 [Mate] (-424.2641 mm): Final Design Frame:1 ↔ 3842993703_STRUT PROFILE 30x30_h150_260915130444799:1
- BR_Constraint_Mate_090413481594026_P4 [Mate] (424.2641 mm): Final Design Frame:1 ↔ 3842993703_STRUT PROFILE 30x30_h150_260915130444799:1
- BR_Constraint_Angle_090413481594026_P5 [Angle] (0 deg): 3842993703_STRUT PROFILE 30x30_h150_260915130444799:1
- BR_Constraint_Mate_090413531539226_P1 [Mate]: Final Design Frame:1 ↔ 3842993703_STRUT PROFILE 30x30_h150_260915130449323:1
- BR_Constraint_Mate_090413531539226_P2 [Mate]: Final Design Frame:1 ↔ 3842993703_STRUT PROFILE 30x30_h150_260915130449323:1
- BR_Constraint_Mate_090413531539226_P3 [Mate] (-424.2641 mm): Final Design Frame:1 ↔ 3842993703_STRUT PROFILE 30x30_h150_260915130449323:1
- BR_Constraint_Mate_090413531539226_P4 [Mate] (424.2641 mm): Final Design Frame:1 ↔ 3842993703_STRUT PROFILE 30x30_h150_260915130449323:1
- BR_Constraint_Angle_090413531539226_P5 [Angle] (0 deg): 3842993703_STRUT PROFILE 30x30_h150_260915130449323:1
- BR_Constraint_Mate_TCon_FC_914260009111513_1_1 [Mate]: 3842993703_STRUT PROFILE 30x30_h150_260915130444799:1 ↔ 3842554447_45° CONNECTOR, 30X30_h150_260915131100914
- BR_Constraint_Mate_TCon_FC_914260009111513_2_2 [Mate]: 3842993703_STRUT PROFILE 30x30_h150_260915130444799:1 ↔ 3842554447_45° CONNECTOR, 30X30_h150_260915131100914
- BR_Constraint_Flush_FCon_FC_914260009111513_1_3 [Flush]: 3842993703_STRUT PROFILE 30x30_h150_260915130444799:1 ↔ 3842554447_45° CONNECTOR, 30X30_h150_260915131100914
- BR_Constraint_Mate_TCon_FC_065265409111513_1_1 [Mate]: 3842993703_STRUT PROFILE 30x30_h150_260915130449323:1 ↔ 3842554447_45° CONNECTOR, 30X30_h150_260915131154065
- BR_Constraint_Mate_TCon_FC_065265409111513_2_2 [Mate]: 3842993703_STRUT PROFILE 30x30_h150_260915130449323:1 ↔ 3842554447_45° CONNECTOR, 30X30_h150_260915131154065
- BR_Constraint_Flush_FCon_FC_065265409111513_1_3 [Flush]: 3842993703_STRUT PROFILE 30x30_h150_260915130449323:1 ↔ 3842554447_45° CONNECTOR, 30X30_h150_260915131154065
- BR_Constraint_Mate_TCon_FC_759260609141513_1_1 [Mate]: 3842993703_STRUT PROFILE 30x30_h150_260914152813741:1 ↔ 3842554447_45° CONNECTOR, 30X30_h150_260915131406759
- BR_Constraint_Mate_TCon_FC_759260609141513_2_2 [Mate]: 3842993703_STRUT PROFILE 30x30_h150_260914152813741:1 ↔ 3842554447_45° CONNECTOR, 30X30_h150_260915131406759
- BR_Constraint_Flush_FCon_FC_759260609141513_1_3 [Flush]: 3842993703_STRUT PROFILE 30x30_h150_260914152813741:1 ↔ 3842554447_45° CONNECTOR, 30X30_h150_260915131406759
- BR_Constraint_Mate_TCon_FC_422263309141513_1_1 [Mate]: 3842993703_STRUT PROFILE 30x30_h150_260914152806460:1 ↔ 3842554447_45° CONNECTOR, 30X30_h150_260915131433422
- BR_Constraint_Mate_TCon_FC_422263309141513_2_2 [Mate]: 3842993703_STRUT PROFILE 30x30_h150_260914152806460:1 ↔ 3842554447_45° CONNECTOR, 30X30_h150_260915131433422
- BR_Constraint_Flush_FCon_FC_422263309141513_1_3 [Flush]: 3842993703_STRUT PROFILE 30x30_h150_260914152806460:1 ↔ 3842554447_45° CONNECTOR, 30X30_h150_260915131433422
- BR_Constraint_Flush_BC_954265409221513_1_1 [Flush] (-20 mm): 3842993724_STRUT PROFILE 40x40L_h150_260914151208250:1 ↔ 3842551604_GUSSET 40X80_h150_260915132254954
- BR_Constraint_Mate_BC_954265409221513_1_3 [Flush] (20 mm): 3842993724_STRUT PROFILE 40x40L_h150_260914151227681:1 ↔ 3842551604_GUSSET 40X80_h150_260915132254954
- BR_Constraint_Flush_BC_954265409221513_1_2 [Flush]: 3842993724_STRUT PROFILE 40x40L_h150_260914151208250:1 ↔ 3842551604_GUSSET 40X80_h150_260915132254954
- BR_Constraint_Mate_BC_821261309231513_1_1 [Mate] (20 mm): 3842993724_STRUT PROFILE 40x40L_h150_260914151219216:1 ↔ 3842551604_GUSSET 40X80_h150_260915132313821
- BR_Constraint_Mate_BC_821261309231513_1_3 [Flush] (20 mm): 3842993724_STRUT PROFILE 40x40L_h150_260914151227681:1 ↔ 3842551604_GUSSET 40X80_h150_260915132313821
- BR_Constraint_Flush_BC_821261309231513_1_2 [Flush]: 3842993724_STRUT PROFILE 40x40L_h150_260914151219216:1 ↔ 3842551604_GUSSET 40X80_h150_260915132313821
- BR_Constraint_Mate_BC_990263809251513_1_1 [Mate] (15 mm): 3842993703_STRUT PROFILE 30x30_h150_260915130427114:1 ↔ 3842523541_GUSSET 30_60_h150_260915132538990
- BR_Constraint_Mate_BC_990263809251513_1_3 [Flush] (15 mm): 3842993703_STRUT PROFILE 30x30_h150_260915130440308:1 ↔ 3842523541_GUSSET 30_60_h150_260915132538990
- BR_Constraint_Flush_BC_990263809251513_1_2 [Flush]: 3842993703_STRUT PROFILE 30x30_h150_260915130427114:1 ↔ 3842523541_GUSSET 30_60_h150_260915132538990
- BR_Constraint_Flush_BC_470261209261513_1_1 [Flush] (-15 mm): 3842993703_STRUT PROFILE 30x30_h150_260915130435922:1 ↔ 3842523541_GUSSET 30_60_h150_260915132612470
- BR_Constraint_Mate_BC_470261209261513_1_3 [Flush] (15 mm): 3842993703_STRUT PROFILE 30x30_h150_260915130427114:1 ↔ 3842523541_GUSSET 30_60_h150_260915132612470
- BR_Constraint_Flush_BC_470261209261513_1_2 [Flush]: 3842993703_STRUT PROFILE 30x30_h150_260915130435922:1 ↔ 3842523541_GUSSET 30_60_h150_260915132612470
- BR_Constraint_Mate_BC_441262309231916_1_1 [Mate] (15 mm): 3842993703_STRUT PROFILE 30x30_h150_260915130427114:1 ↔ 3842523530_GUSSET 30_30_h150_260919162323441
- BR_Constraint_Mate_BC_441262309231916_1_3 [Mate] (-15 mm): 3842993703_STRUT PROFILE 30x30_h150_260915130422752:1 ↔ 3842523530_GUSSET 30_30_h150_260919162323441
- BR_Constraint_Mate_BC_441262309231916_1_2 [Mate]: 3842993703_STRUT PROFILE 30x30_h150_260915130427114:1 ↔ 3842523530_GUSSET 30_30_h150_260919162323441
- BR_Constraint_Mate_BC_887262809231916_1_1 [Mate] (15 mm): 3842993703_STRUT PROFILE 30x30_h150_260915130422752:1 ↔ 3842523530_GUSSET 30_30_h150_260919162328887
- BR_Constraint_Mate_BC_887262809231916_1_3 [Flush] (15 mm): 3842993703_STRUT PROFILE 30x30_h150_260915130440308:1 ↔ 3842523530_GUSSET 30_30_h150_260919162328887
- BR_Constraint_Flush_BC_887262809231916_1_2 [Flush]: 3842993703_STRUT PROFILE 30x30_h150_260915130422752:1 ↔ 3842523530_GUSSET 30_30_h150_260919162328887
- BR_Constraint_Mate_BC_955263809231916_1_1 [Mate] (20 mm): 3842993724_STRUT PROFILE 40x40L_h150_260914151227681:1 ↔ 3842523530_GUSSET 30_30_h150_260919162338955
- BR_Constraint_Mate_BC_955263809231916_1_3 [Flush] (15 mm): 3842993703_STRUT PROFILE 30x30_h150_260915130417955:1 ↔ 3842523530_GUSSET 30_30_h150_260919162338955
- BR_Constraint_Mate_BC_955263809231916_1_2 [Mate]: 3842993724_STRUT PROFILE 40x40L_h150_260914151227681:1 ↔ 3842523530_GUSSET 30_30_h150_260919162338955
- BR_Constraint_Mate_BC_830261309241916_1_1 [Mate] (20 mm): 3842993724_STRUT PROFILE 40x40L_h150_260914151219216:1 ↔ 3842523530_GUSSET 30_30_h150_260919162413830
- BR_Constraint_Mate_BC_830261309241916_1_3 [Mate] (-22.5 mm): 3842993710_STRUT PROFILE 30x45_h150_260914151454532:1 ↔ 3842523530_GUSSET 30_30_h150_260919162413830
- BR_Constraint_Flush_BC_830261309241916_1_2 [Flush]: 3842993724_STRUT PROFILE 40x40L_h150_260914151219216:1 ↔ 3842523530_GUSSET 30_30_h150_260919162413830
- BR_Constraint_Flush_BC_326262109241916_1_1 [Flush] (-20 mm): 3842993724_STRUT PROFILE 40x40L_h150_260914151223655:1 ↔ 3842523530_GUSSET 30_30_h150_260919162421326
- BR_Constraint_Mate_BC_326262109241916_1_3 [Flush] (22.5 mm): 3842993710_STRUT PROFILE 30x45_h150_260914151454532:1 ↔ 3842523530_GUSSET 30_30_h150_260919162421326
- BR_Constraint_Mate_BC_326262109241916_1_2 [Mate]: 3842993724_STRUT PROFILE 40x40L_h150_260914151223655:1 ↔ 3842523530_GUSSET 30_30_h150_260919162421326
- BR_Constraint_Flush_BC_977262809241916_1_1 [Flush] (-20 mm): 3842993724_STRUT PROFILE 40x40L_h150_260914151208250:1 ↔ 3842523530_GUSSET 30_30_h150_260919162428977
- BR_Constraint_Mate_BC_977262809241916_1_3 [Mate] (-22.5 mm): 3842993710_STRUT PROFILE 30x45_h150_260914151506771:1 ↔ 3842523530_GUSSET 30_30_h150_260919162428977
- BR_Constraint_Flush_BC_977262809241916_1_2 [Flush]: 3842993724_STRUT PROFILE 40x40L_h150_260914151208250:1 ↔ 3842523530_GUSSET 30_30_h150_260919162428977
- BR_Constraint_Flush_BC_648263509241916_1_1 [Flush] (-20 mm): 3842993724_STRUT PROFILE 40x40L_h150_260914151213792:1 ↔ 3842523530_GUSSET 30_30_h150_260919162435648
- BR_Constraint_Mate_BC_648263509241916_1_3 [Flush] (22.5 mm): 3842993710_STRUT PROFILE 30x45_h150_260914151506771:1 ↔ 3842523530_GUSSET 30_30_h150_260919162435648
- BR_Constraint_Mate_BC_648263509241916_1_2 [Mate]: 3842993724_STRUT PROFILE 40x40L_h150_260914151213792:1 ↔ 3842523530_GUSSET 30_30_h150_260919162435648
- BR_Constraint_Mate_BC_492263609261916_1_1 [Mate] (15 mm): 3842993710_STRUT PROFILE 30x45_h150_260914152035980:1 ↔ 3842523530_GUSSET 30_30_h150_260919162636492
- BR_Constraint_Mate_BC_492263609261916_1_3 [Flush] (15 mm): 3842993710_STRUT PROFILE 30x45_h150_260914152246414:1 ↔ 3842523530_GUSSET 30_30_h150_260919162636492